# Autodesk Inventor assembly: LedUnidad
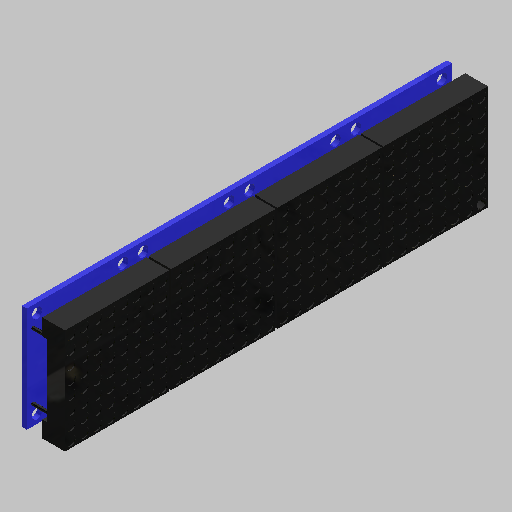
[picture p0: Inventor's stored thumbnail of the model, 512x512]
Saved by Autodesk Inventor 2027 (Build 310192000, 192)
## iProperties
Created: 2026-11-23
Part Number: LedUnidad
Document SubType Name: Assembly
Designer: Alexander
Author: Alexander
## Documents named in this file (3)
- C:\Users\Alexander\Documents\Propuesta_Modelo_3D\Propuesta_Modelo_3D\Modelo V2\LedUnidad.iam
- C:\Users\Alexander\Documents\Propuesta_Modelo_3D\Propuesta_Modelo_3D\Modelo V2\PCB_MATRIZ.ipt
- C:\Users\Alexander\Documents\Propuesta_Modelo_3D\Propuesta_Modelo_3D\Modelo V2\LED_MATRIZ.ipt
## Components (2 placed, 2 different names)
1. PCB_MATRIZ:1 — Coincidencia:1, Nivelación:1, Nivelación:2
2. LED_MATRIZ:1 — Coincidencia:1, Nivelación:1, Nivelación:2
## Relationships (3: Flush 2, Mate 1)
- Coincidencia:1 [Mate]: PCB_MATRIZ:1 ↔ LED_MATRIZ:1
- Nivelación:1 [Flush]: PCB_MATRIZ:1 ↔ LED_MATRIZ:1
- Nivelación:2 [Flush]: PCB_MATRIZ:1 ↔ LED_MATRIZ:1
